# Autodesk Inventor assembly: sliding-assembly_mizuno
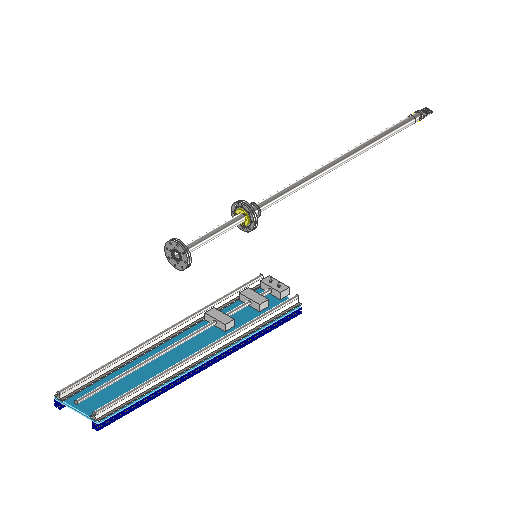
[picture p0: Inventor's stored thumbnail of the model, 512x512]
Saved by Autodesk Inventor 2027.1 (Build 311270010, 270A)
## iProperties
Created: 2026-06-04
Part Number: sliding-assembly_mizuno
Document SubType Name: Assembly
Designer: shusu
Author: shusu
## Documents named in this file (11)
- D:\repos\PIHTI\bellows-probe_mizuno\sliding-assembly_mizuno.iam
- D:\repos\PIHTI\bellows-probe_mizuno\rail bwllows probe.ipt
- D:\repos\PIHTI\bellows-probe_mizuno\Al-profile-30x30-L1000.ipt
- D:\repos\PIHTI\ContentCenter\Aluminium-profiles\Al-profile-30x30.ipt
- D:\repos\PIHTI\bellows-probe_mizuno\base-plate-for-bellows.ipt
- D:\repos\PIHTI\ContentCenter\Fastners\M6x16-SHCS.ipt
- D:\repos\PIHTI\bellows-probe_mizuno\M16-lead-screw.ipt
- D:\repos\PIHTI\bellows-probe_mizuno\lead-screw-nut-preview.ipt
- C:\Users\queezz\Dropbox\Drawings\pihti-cad\ContentCenter\Fastners\m8-nut.ipt
- C:\Users\queezz\Dropbox\Drawings\pihti-cad\ContentCenter\Fastners\M8x45-HexCS.ipt
- D:\repos\PIHTI\BoronProbe_2026\BoronProbe_2026_non-rotating_slide.iam
## Components (44 placed, 9 different names)
1. rail:1 — メイト:9, フラッシュ:22, メイト:30
2. rail:2 — メイト:9, メイト:16, フラッシュ:12, フラッシュ:20
3. Al-profile-30x30-L1000:1 — メイト:18, フラッシュ:13, フラッシュ:16
4. Al-profile-30x30-L1000:2 — メイト:17, フラッシュ:14, フラッシュ:15
5. base-plate-for-bellows:1 — メイト:16, フラッシュ:11, フラッシュ:12, メイト:17, メイト:18, フラッシュ:13, フラッシュ:14, フラッシュ:15, フラッシュ:16, フラッシュ:22, メイト:30
6. M16-lead-screw:1 — メイト:26, フラッシュ:20, メイト:34, メイト:35
7. lead-screw-nut-preview:1 — メイト:26
8. lead-screw-nut-preview:2 — メイト:34
9. lead-screw-nut-preview:4 — メイト:35
10. BoronProbe_2026_non-rotating_slide:1 [sub-assembly]
11. AS 1112 (2) - Metric M8  Type 5:1
12. AS 1427 - Metric M8 x 45:1
13. AS 1427 - Metric M8 x 45:2
14. AS 1112 (2) - Metric M8  Type 5:2
15. AS 1427 - Metric M8 x 45:3
16. AS 1427 - Metric M8 x 45:4
17. AS 1427 - Metric M8 x 45:5
18. AS 1427 - Metric M8 x 45:6
19. AS 1427 - Metric M8 x 45:7
20. AS 1427 - Metric M8 x 45:8
21. AS 1427 - Metric M8 x 45:9
22. AS 1427 - Metric M8 x 45:10
23. AS 1427 - Metric M8 x 45:11
24. AS 1427 - Metric M8 x 45:12
25. AS 1427 - Metric M8 x 45:13
26. AS 1427 - Metric M8 x 45:14
27. AS 1427 - Metric M8 x 45:15
28. AS 1427 - Metric M8 x 45:16
29. AS 1112 (2) - Metric M8  Type 5:3
30. AS 1112 (2) - Metric M8  Type 5:4
31. AS 1112 (2) - Metric M8  Type 5:5
32. AS 1112 (2) - Metric M8  Type 5:6
33. AS 1112 (2) - Metric M8  Type 5:7
34. AS 1112 (2) - Metric M8  Type 5:8
35. AS 1112 (2) - Metric M8  Type 5:9
36. AS 1112 (2) - Metric M8  Type 5:10
37. AS 1112 (2) - Metric M8  Type 5:11
38. AS 1112 (2) - Metric M8  Type 5:12
39. AS 1112 (2) - Metric M8  Type 5:13
40. AS 1112 (2) - Metric M8  Type 5:14
41. AS 1112 (2) - Metric M8  Type 5:15
42. AS 1112 (2) - Metric M8  Type 5:16
43. JIS B 1176 - Metric M6 x 16:3
44. JIS B 1176 - Metric M6 x 16:4
## Relationships (16: Mate 8, Flush 8)
- メイト:9 [Mate] (175 mm): rail:1 ↔ rail:2
- メイト:16 [Mate]: rail:2 ↔ base-plate-for-bellows:1
- フラッシュ:11 [Flush]: base-plate-for-bellows:1
- フラッシュ:12 [Flush]: rail:2 ↔ base-plate-for-bellows:1
- メイト:17 [Mate]: Al-profile-30x30-L1000:2 ↔ base-plate-for-bellows:1
- メイト:18 [Mate]: Al-profile-30x30-L1000:1 ↔ base-plate-for-bellows:1
- フラッシュ:13 [Flush]: Al-profile-30x30-L1000:1 ↔ base-plate-for-bellows:1
- フラッシュ:14 [Flush]: Al-profile-30x30-L1000:2 ↔ base-plate-for-bellows:1
- フラッシュ:15 [Flush]: Al-profile-30x30-L1000:2 ↔ base-plate-for-bellows:1
- フラッシュ:16 [Flush]: Al-profile-30x30-L1000:1 ↔ base-plate-for-bellows:1
- メイト:26 [Mate]: M16-lead-screw:1 ↔ lead-screw-nut-preview:1
- フラッシュ:20 [Flush]: rail:2 ↔ M16-lead-screw:1
- フラッシュ:22 [Flush]: rail:1 ↔ base-plate-for-bellows:1
- メイト:30 [Mate]: rail:1 ↔ base-plate-for-bellows:1
- メイト:34 [Mate]: M16-lead-screw:1 ↔ lead-screw-nut-preview:2
- メイト:35 [Mate]: M16-lead-screw:1 ↔ lead-screw-nut-preview:4
